# Autodesk Inventor assembly: dau_robot
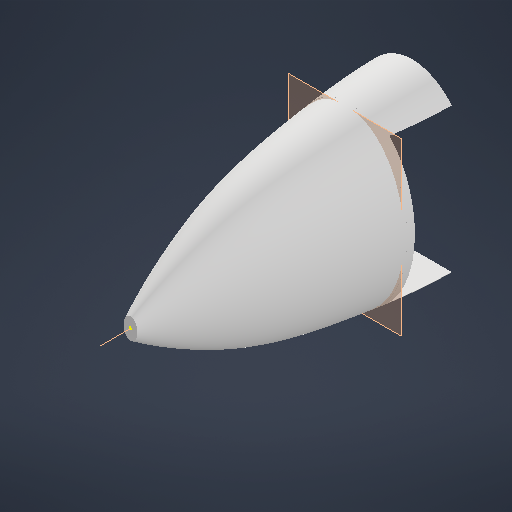
[picture p0: Inventor's stored thumbnail of the model, 512x512]
Saved by Autodesk Inventor 2027 (Build 310192060, 192F)
## iProperties
Created: 2026-08-27
Part Number: dau_robot
Document SubType Name: Assembly
Designer: DELL
Author: DELL
## Documents named in this file (4)
- D:\Downloads\head\Workgroups\NotInProject\dau_robot.iam
- D:\Downloads\head\Workgroups\NotInProject\head.ipt
- D:\Downloads\head\Workgroups\NotInProject\nap_dau_ca.ipt
- D:\Downloads\head\Workgroups\NotInProject\solid_in_head.ipt
## Components (3 placed, 3 different names)
1. head:1 — Rigid:1
2. nap_dau_ca:1 — Mate:1, Rigid:1
3. solid_in_head:1 — Mate:1
## Relationships (2: Mate 1, WeldJoint 1)
- Mate:1: nap_dau_ca:1 ↔ solid_in_head:1
- Rigid:1 [WeldJoint]: head:1 ↔ nap_dau_ca:1
